# Autodesk Inventor assembly: carcasa
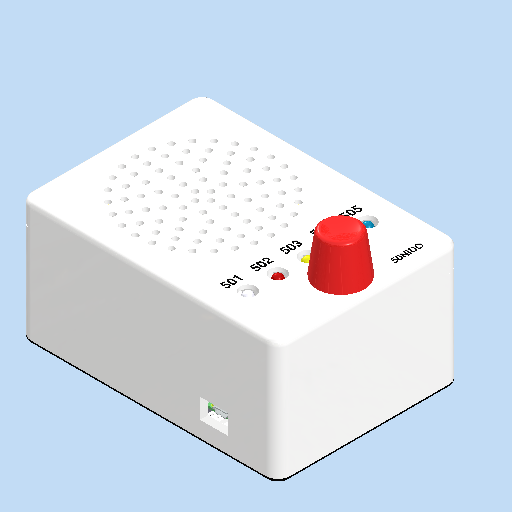
[picture p0: Inventor's stored thumbnail of the model, 512x512]
Saved by Autodesk Inventor 2026.3 (Build 303398000, 398)
## iProperties
Created: 2026-11-01
Part Number: carcasa
Document SubType Name: Assembly
Designer: Hp
Author: Hp
## Documents named in this file (13)
- C:\Users\Hp\Documents\GitHub\dis8645-2026-2-procesos-2\00-proyecto-2\grupo-01\carcasa\ensambles\carcasa.iam
- C:\Users\Hp\Documents\GitHub\dis8645-2026-2-procesos-2\00-proyecto-2\grupo-01\carcasa\piezas\tapa-frontal.ipt
- C:\Users\Hp\Documents\GitHub\dis8645-2026-2-procesos-2\00-proyecto-2\grupo-01\carcasa\stl\tapa-inferior.ipt
- C:\Users\Hp\Documents\GitHub\dis8645-2026-2-procesos-2\00-proyecto-2\grupo-01\carcasa\piezas\parlante.ipt
- C:\Users\Hp\Documents\GitHub\dis8645-2026-2-procesos-2\00-proyecto-2\grupo-01\carcasa\piezas\protoboard\protoboard.ipt
- C:\Users\Hp\Documents\GitHub\dis8645-2026-2-procesos-2\00-proyecto-2\grupo-01\carcasa\piezas\raspi\raspi.ipt
- C:\Users\Hp\Documents\GitHub\dis8645-2026-2-procesos-2\00-proyecto-2\grupo-01\carcasa\piezas\Encoder KY-040\encoder-ky-040.ipt
- C:\Users\Hp\Documents\GitHub\dis8645-2026-2-procesos-2\00-proyecto-2\grupo-01\carcasa\piezas\max98357a\max98357a.ipt
- C:\Users\Hp\Documents\GitHub\dis8645-2026-2-procesos-2\00-proyecto-2\grupo-01\carcasa\piezas\POT10K\POT10K.ipt
- C:\Users\Hp\Documents\GitHub\dis8645-2026-2-procesos-2\00-proyecto-2\grupo-01\carcasa\piezas\bouton_12x12mm\bouton-12x12mm.ipt
- C:\Users\Hp\Documents\GitHub\dis8645-2026-2-procesos-2\00-proyecto-2\grupo-01\carcasa\piezas\000replacement-knob-generator.ipt
- C:\Users\Hp\Documents\GitHub\dis8645-2026-2-procesos-2\00-proyecto-2\grupo-01\carcasa\piezas\led5mm\led5mm.ipt
- C:\Users\Hp\Documents\GitHub\dis8645-2026-2-procesos-2\00-proyecto-2\grupo-01\carcasa\stl\pieza1.ipt
## Components (17 placed, 12 different names)
1. tapa-inferior:1 — Nivelación:3, Coincidencia:1, Nivelación:4, Nivelación:5, Coincidencia:5, Coincidencia:12, Coincidencia:13, Coincidencia:14, Ángulo:1, Coincidencia:20, Coincidencia:21, Ángulo:4, Coincidencia:22
2. parlante:1 — Coincidencia:2, Coincidencia:3
3. tapa-frontal:1 — Coincidencia:1, Nivelación:4, Nivelación:5, Coincidencia:2, Coincidencia:3, Coincidencia:9, Coincidencia:15, Coincidencia:16, Ángulo:2, Coincidencia:24, Coincidencia:25, Coincidencia:26, Coincidencia:27, Coincidencia:28, Coincidencia:29, Tangente:1, Tangente:2, Tangente:3, Tangente:4, Tangente:5
4. protoboard:1 — Coincidencia:4, Nivelación:6, Nivelación:7, Coincidencia:5, Coincidencia:6, Ángulo:3, Coincidencia:18, Coincidencia:19
5. protoboard:2 — Coincidencia:4, Nivelación:6, Nivelación:7, Coincidencia:7, Coincidencia:9, Coincidencia:10, Coincidencia:11, Coincidencia:12
6. raspi:1 — Coincidencia:6, Coincidencia:7, Coincidencia:10, Coincidencia:11
7. encoder-ky-040:1 — Coincidencia:15, Coincidencia:16, Ángulo:2, Coincidencia:30
8. max98357a:1 — Ángulo:3, Coincidencia:18, Coincidencia:19
9. POT10K:1 — Coincidencia:13, Coincidencia:14, Ángulo:1, Coincidencia:23
10. bouton-12x12mm:1 — Coincidencia:20, Coincidencia:21, Ángulo:4
11. 000replacement-knob-generator:1 — Coincidencia:22, Coincidencia:23
12. led5mm:1 — Coincidencia:26, Tangente:5
13. led5mm:2 — Coincidencia:27, Tangente:4
14. led5mm:3 — Coincidencia:28, Tangente:1
15. led5mm:4 — Coincidencia:25, Tangente:2
16. led5mm:5 — Coincidencia:24, Tangente:3
17. pieza1:1 — Coincidencia:29, Coincidencia:30
## Relationships (42: Mate 28, Flush 5, Tangent 5, Angle 4)
- Nivelación:3 [Flush]: tapa-inferior:1
- Coincidencia:1 [Mate]: tapa-inferior:1 ↔ tapa-frontal:1
- Nivelación:4 [Flush]: tapa-inferior:1 ↔ tapa-frontal:1
- Nivelación:5 [Flush]: tapa-inferior:1 ↔ tapa-frontal:1
- Coincidencia:2 [Mate]: parlante:1 ↔ tapa-frontal:1
- Coincidencia:3 [Mate]: parlante:1 ↔ tapa-frontal:1
- Coincidencia:4 [Mate]: protoboard:1 ↔ protoboard:2
- Nivelación:6 [Flush]: protoboard:1 ↔ protoboard:2
- Nivelación:7 [Flush]: protoboard:1 ↔ protoboard:2
- Coincidencia:5 [Mate]: tapa-inferior:1 ↔ protoboard:1
- Coincidencia:6 [Mate]: protoboard:1 ↔ raspi:1
- Coincidencia:7 [Mate]: protoboard:2 ↔ raspi:1
- Coincidencia:9 [Mate]: tapa-frontal:1 ↔ protoboard:2
- Coincidencia:10 [Mate]: protoboard:2 ↔ raspi:1
- Coincidencia:11 [Mate]: protoboard:2 ↔ raspi:1
- Coincidencia:12 [Mate] (3.8 mm): tapa-inferior:1 ↔ protoboard:2
- Coincidencia:13 [Mate] (4 mm): tapa-inferior:1 ↔ POT10K:1
- Coincidencia:14 [Mate]: tapa-inferior:1 ↔ POT10K:1
- Ángulo:1 [Angle] (0 deg): tapa-inferior:1 ↔ POT10K:1
- Coincidencia:15 [Mate]: tapa-frontal:1 ↔ encoder-ky-040:1
- Coincidencia:16 [Mate]: tapa-frontal:1 ↔ encoder-ky-040:1
- Ángulo:2 [Angle] (0 deg): tapa-frontal:1 ↔ encoder-ky-040:1
- Ángulo:3 [Angle] (0 deg): protoboard:1 ↔ max98357a:1
- Coincidencia:18 [Mate]: protoboard:1 ↔ max98357a:1
- Coincidencia:19 [Mate]: protoboard:1 ↔ max98357a:1
- Coincidencia:20 [Mate]: tapa-inferior:1 ↔ bouton-12x12mm:1
- Coincidencia:21 [Mate]: tapa-inferior:1 ↔ bouton-12x12mm:1
- Ángulo:4 [Angle] (0 deg): tapa-inferior:1 ↔ bouton-12x12mm:1
- Coincidencia:22 [Mate]: tapa-inferior:1 ↔ 000replacement-knob-generator:1
- Coincidencia:23 [Mate]: POT10K:1 ↔ 000replacement-knob-generator:1
- Coincidencia:24 [Mate]: tapa-frontal:1 ↔ led5mm:5
- Coincidencia:25 [Mate]: tapa-frontal:1 ↔ led5mm:4
- Coincidencia:26 [Mate]: tapa-frontal:1 ↔ led5mm:1
- Coincidencia:27 [Mate]: tapa-frontal:1 ↔ led5mm:2
- Coincidencia:28 [Mate]: tapa-frontal:1 ↔ led5mm:3
- Coincidencia:29 [Mate]: tapa-frontal:1 ↔ pieza1:1
- Coincidencia:30 [Mate]: encoder-ky-040:1 ↔ pieza1:1
- Tangente:1 (-5 mm): tapa-frontal:1 ↔ led5mm:3
- Tangente:2 (-5 mm): tapa-frontal:1 ↔ led5mm:4
- Tangente:3 (-5 mm): tapa-frontal:1 ↔ led5mm:5
- Tangente:4 (-5 mm): tapa-frontal:1 ↔ led5mm:2
- Tangente:5 (-5 mm): tapa-frontal:1 ↔ led5mm:1
## Named parameters: Finish10_Area = 1.70253, Finish11_Area = 1.70253, Finish12_Area = 1.70253, Finish13_Area = 1.70449, Finish14_Area = 1.70253, Finish15_Area = 24.7133, Finish1_Area = 1.0044, Finish2_Area = 0.24679, Finish3_Area = 8.17987, Finish4_Area = 8.17987, Finish5_Area = 1.07308, Finish6_Area = 4.81148, Finish7_Area = 744.604, Finish8_Area = 426.5, Finish9_Area = 1.70253
note: some values were not read from the file. Shown as the stored number, unit unknown: "Finish10_Area", "Finish11_Area", "Finish12_Area", "Finish13_Area", "Finish14_Area", "Finish15_Area", "Finish1_Area", "Finish2_Area", "Finish3_Area", "Finish4_Area", "Finish5_Area", "Finish6_Area", "Finish7_Area", "Finish8_Area", "Finish9_Area".
